# Autodesk Inventor assembly: 车轮车轴组合
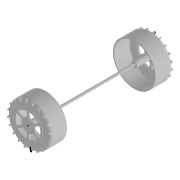
[picture p0: Inventor's stored thumbnail of the model, 180x180]
Saved by Autodesk Inventor 2021 (Build 250183000, 183)
## iProperties
Created: 2024-05-13
Part Number: 车轮车轴组合
Document SubType Name: Assembly
Designer: teacher
Author: teacher
## Documents named in this file (3)
- C:\Users\teacher\Desktop\月球车模型-姓名\车轮车轴组合.iam
- C:\Users\teacher\Desktop\月球车模型-姓名\轮子(36mm).ipt
- C:\Users\teacher\Desktop\月球车模型-姓名\轴(2mm 80mm).ipt
## Components (3 placed, 2 different names)
1. 轮子(36mm):1 — 插入:1
2. 轮子(36mm):2 — 圆柱:1
3. 轴(2mm 80mm):1 — 插入:1, 圆柱:1
## Relationships (2: Insert 1, CylindricalJoint 1)
- 插入:1 [Insert]: 轮子(36mm):1 ↔ 轴(2mm 80mm):1
- 圆柱:1 [CylindricalJoint]: 轮子(36mm):2 ↔ 轴(2mm 80mm):1
